# Autodesk Inventor assembly: field_robot
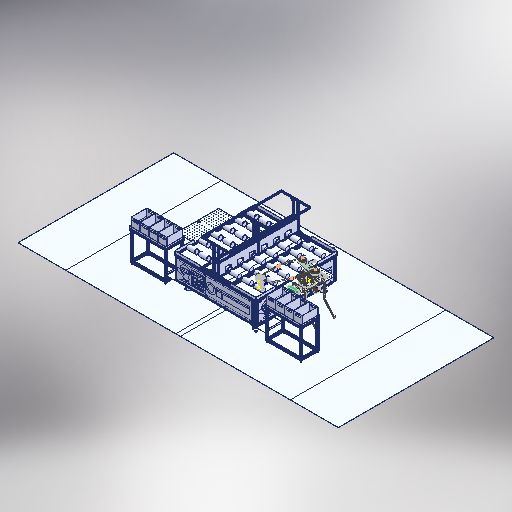
[picture p0: Inventor's stored thumbnail of the model, 512x512]
Saved by Autodesk Inventor 2025.3 (Build 293356030, 356C)
## iProperties
Created: 2026-06-07
Part Number: field_robot
Document SubType Name: Assembly
Designer: ibuki_ono
Author: ibuki_ono
## Documents named in this file (3)
- C:\Users\ibuki_ono\Documents\hobby\rogiken\catchrobo\2026_CAD\Hardware_2026\Inventor\field_robot.iam
- C:\Users\ibuki_ono\Documents\hobby\rogiken\catchrobo\2026_CAD\Hardware_2026\Inventor\field\234_2026_fh_st\234_2026_fh_st\234_2026_fh_st.iam
- C:\Users\ibuki_ono\Documents\hobby\rogiken\catchrobo\2026_CAD\Hardware_2026\Inventor\robot.iam
## Components (2 placed, 2 different names)
1. 234_2026_fh_st:1 [sub-assembly] — メイト:1, 角度:1, メイト:2, フラッシュ:1, フラッシュ:2
2. robot:1 [sub-assembly] — メイト:1, 角度:1, メイト:2, フラッシュ:1, フラッシュ:2
## Relationships (5: Mate 2, Flush 2, Angle 1)
- メイト:1 [Mate]: 234_2026_fh_st:1 ↔ robot:1
- 角度:1 [Angle] (0 deg): 234_2026_fh_st:1 ↔ robot:1
- メイト:2 [Mate]: 234_2026_fh_st:1 ↔ robot:1
- フラッシュ:1 [Flush]: 234_2026_fh_st:1 ↔ robot:1
- フラッシュ:2 [Flush] (150 mm): 234_2026_fh_st:1 ↔ robot:1
